# Autodesk Inventor assembly: XT60_Assembly.ipt
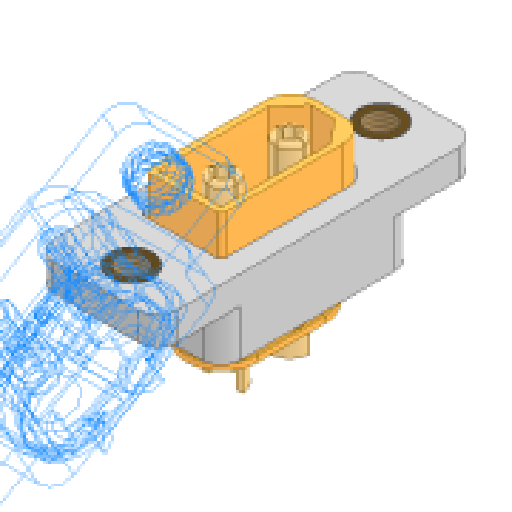
[picture p0: Inventor's stored thumbnail of the model, 512x512]
Saved by Autodesk Inventor 2025 (Build 290162000, 162)
## iProperties
Created: 2024-11-15
Part Number: XT60_Assembly.ipt
Document SubType Name: Assembly
Designer: OSB
Mass: 5 g
Surface Area: 41.9296 cm^2
Volume: 2.60932 cm^3
Sending System: Autodesk Inventor 2021
Preprocessor: unknown
Minimum Resolution: 0.01
Sent Units: Millimeter
Translation Standard: IGES 5.3
Model Creation Time: 2020-07-07
Title: S500 Frame
Author: OSB
## Documents named in this file (4)
- C:\Users\OSB\Desktop\SB\1.Projects\캡스톤 디자인(2)_Paper\Modeling\Implementation_Design\Ver_004_mass_update\XT60_Assembly.ipt.iam
- C:\Users\OSB\Desktop\SB\1.Projects\캡스톤 디자인(2)_Paper\Modeling\Implementation_Design\Ver_004_mass_update\XT60_Male_Connector.ipt
- C:\Users\OSB\Desktop\SB\1.Projects\캡스톤 디자인(2)_Paper\Modeling\Implementation_Design\Ver_004_mass_update\XT60_Male_Mount.ipt
- C:\Users\OSB\Desktop\SB\1.Projects\캡스톤 디자인(2)_Paper\Modeling\Implementation_Design\Ver_004_mass_update\InsertNut_M3.ipt
## Components (4 placed, 3 different names)
1. XT60_Male_Connector:1 — 메이트:1, 메이트:2, 메이트:3
2. XT60_Male_Mount:1 — 메이트:1, 메이트:2, 메이트:3
3. InsertNut_M3:1
4. InsertNut_M3:2
## Relationships (3: Mate 3)
- 메이트:1 [Mate]: XT60_Male_Connector:1 ↔ XT60_Male_Mount:1
- 메이트:2 [Mate] (0.25 mm): XT60_Male_Connector:1 ↔ XT60_Male_Mount:1
- 메이트:3 [Mate] (0.25 mm): XT60_Male_Connector:1 ↔ XT60_Male_Mount:1
